# Autodesk Inventor assembly: CPS Team 1_Full Base Model
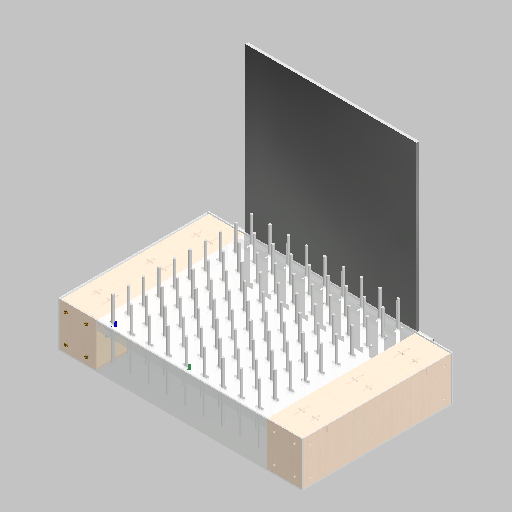
[picture p0: Inventor's stored thumbnail of the model, 512x512]
Saved by Autodesk Inventor 2026.1 (Build 301233000, 233)
## iProperties
Created: 2026-11-04
Part Number: CPS Team 1_Full Base Model
Document SubType Name: Assembly
Designer: FerdiaComerford
Author: FerdiaComerford
## iProperties of the stored document rear bearing.ipt
Created: 2026-11-04
Part Number: rear bearing
Material: Generic
Document SubType Name: Modeling
Designer: FerdiaComerford
Density: 1 g/cm^3
Appearance: Default
Author: FerdiaComerford
## iProperties of the stored document M3x10-Screw.ipt
Created: 2026-11-04
Part Number: M3x10-Screw
Material: Generic
Document SubType Name: Modeling
Designer: FerdiaComerford
Density: 1 g/cm^3
Appearance: Default
Author: FerdiaComerford
## iProperties of the stored document connector.ipt
Created: 2026-11-04
Part Number: connector
Material: Generic
Document SubType Name: Modeling
Designer: FerdiaComerford
Density: 1 g/cm^3
Appearance: Default
Author: FerdiaComerford
## iProperties of the stored document rear end cap.ipt
Created: 2026-11-04
Part Number: rear end cap
Material: Generic
Document SubType Name: Modeling
Designer: FerdiaComerford
Density: 1 g/cm^3
Appearance: Default
Author: FerdiaComerford
## iProperties of the stored document 17HS4401S_Stepper_Motor.iam
Created: 2024-09-10
Part Number: 17HS4401S_Stepper_Motor
Document SubType Name: Assembly
Designer: FerdiaComerford
Title: Open CASCADE Shape Model
Description: FreeCAD Model
Authorization: Unknown
Sending System: FreeCAD
Preprocessor: Open CASCADE STEP processor 7.6
Author: FerdiaComerford
## iProperties of the stored document stator.ipt
Created: 2026-11-04
Part Number: stator
Material: Generic
Document SubType Name: Modeling
Designer: FerdiaComerford
Density: 1 g/cm^3
Appearance: Default
Author: FerdiaComerford
## iProperties of the stored document front bearing.ipt
Created: 2026-11-04
Part Number: front bearing
Material: Generic
Document SubType Name: Modeling
Designer: FerdiaComerford
Density: 1 g/cm^3
Appearance: Default
Author: FerdiaComerford
## iProperties of the stored document front end cap.ipt
Created: 2026-11-04
Part Number: front end cap
Material: Generic
Document SubType Name: Modeling
Designer: FerdiaComerford
Density: 1 g/cm^3
Appearance: Default
Author: FerdiaComerford
## iProperties of the stored document shaft.ipt
Created: 2026-11-04
Part Number: shaft
Material: Generic
Document SubType Name: Modeling
Designer: FerdiaComerford
Density: 1 g/cm^3
Appearance: Default
Author: FerdiaComerford
## Documents named in this file (28)
- C:\Users\FerdiaComerford\Downloads\CPS Team 1_Full Base Model.iam
- C:\Users\FerdiaComerford\Downloads\Wheat Holder Mid Layer.ipt
- C:\Users\FerdiaComerford\Downloads\Wheat Holder Top Layer.ipt
- C:\Users\FerdiaComerford\Downloads\Wheat Holder Bottom Layer.ipt
- C:\Users\FerdiaComerford\Downloads\Wood Box Top.ipt
- C:\Users\FerdiaComerford\Downloads\Wood Box Short Side.ipt
- C:\Users\FerdiaComerford\Downloads\Wood Box Long End.ipt
- C:\Users\FerdiaComerford\Downloads\Acrlic Lond Side.ipt
- C:\Users\FerdiaComerford\Downloads\Acrylic Short Side.ipt
- C:\Users\FerdiaComerford\Downloads\Motor Mount.ipt
- C:\Users\FerdiaComerford\Downloads\Box Base.ipt
- C:\Users\FerdiaComerford\Downloads\support.ipt
- C:\Vault Workspace\CAD DESIGN\Components\FASTENERS\Brass\Brass Bolt Pan\DIN 85_ISO 1580_Brass Bolt Pan\FAS_0071.ipt
- C:\Users\FerdiaComerford\Downloads\Large Support.ipt
- C:\Users\FerdiaComerford\Downloads\Small Support.ipt
- **C:\Users\FerdiaComerford\Downloads\CPS Team 1_Full Base Model.iam*LocalDocs*xAaaaatbaAaaaaaaaAaaaavi0Zg*17HS4401S_Stepper_Motor.iam
- C:\Users\FerdiaComerford\Downloads\Straw.ipt
- C:\Users\FerdiaComerford\Downloads\CAM Shaft 3.ipt
- C:\Users\FerdiaComerford\Downloads\Mirror.ipt
- **C:\Users\FerdiaComerford\Downloads\CPS Team 1_Full Base Model.iam*LocalDocs*xAaaaagbaAaaaaaaaAaaaauxlCd*rear bearing.ipt
- **C:\Users\FerdiaComerford\Downloads\CPS Team 1_Full Base Model.iam*LocalDocs*xAaaaa1caAaaaaaaaAaaaapioAb*M3x10-Screw.ipt
- **C:\Users\FerdiaComerford\Downloads\CPS Team 1_Full Base Model.iam*LocalDocs*xAaaaa0caAaaaaaaaAaaaqgtkPa*connector.ipt
- **C:\Users\FerdiaComerford\Downloads\CPS Team 1_Full Base Model.iam*LocalDocs*xAaaaadcaAaaaaaaaAaaaaojlBe*rear end cap.ipt
- **C:\Users\FerdiaComerford\Downloads\CPS Team 1_Full Base Model.iam*LocalDocs*xAaaaqzdaAaaaaaaaAaaaar4kKc*shaft.ipt
- **C:\Users\FerdiaComerford\Downloads\CPS Team 1_Full Base Model.iam*LocalDocs*xAaaaanbaAaaaaaaaAaaaaue3Lc*stator.ipt
- **C:\Users\FerdiaComerford\Downloads\CPS Team 1_Full Base Model.iam*LocalDocs*xAaaaqldaAaaaaaaaAaaaqvu4Wd*front end cap.ipt
- **C:\Users\FerdiaComerford\Downloads\CPS Team 1_Full Base Model.iam*LocalDocs*xAaaaqvaaAaaaaaaaAaaaqtwsVh*front bearing.ipt
- C:\Users\FerdiaComerford\Downloads\17HS4401S_Stepper_Motor.step
## Components (116 placed, 18 different names)
1. Wheat Holder Mid Layer:1 — Mate:38
2. Wheat Holder Top Layer:1
3. Wheat Holder Bottom Layer:1
4. Wood Box Top:1
5. Wood Box Short Side:1 — Mate:29, Mate:30
6. Wood Box Long End:1 — Mate:33
7. Acrlic Lond Side:1 — Mate:21, Mate:22, Mate:23, Mate:24, Mate:25, Mate:26, Mate:27, Mate:28, Mate:37
8. Acrylic Short Side:1 — Mate:13, Mate:14, Mate:15, Mate:16, Mate:17, Mate:18, Mate:19, Mate:20
9. Motor Mount:1
10. Box Base:1
11. FAS_0071:1 — Mate:15, Mate:20
12. FAS_0071:2 — Mate:14, Mate:19
13. FAS_0071:3 — Mate:16, Mate:18
14. FAS_0071:4 — Mate:13, Mate:17
15. FAS_0071:5 — Mate:23, Mate:26
16. FAS_0071:6 — Mate:21, Mate:28
17. FAS_0071:7 — Mate:24, Mate:25
18. FAS_0071:8 — Mate:22, Mate:27
19. support:1 — Mate:35
20. Large Support:1
21. Small Support:1
22. 17HS4401S_Stepper_Motor:1 [sub-assembly] — Mate:29
23. 17HS4401S_Stepper_Motor:2 [sub-assembly] — Mate:30, Mate:33, Mate:34, Mate:35, Mate:36
24. 17HS4401S_Stepper_Motor:3 [sub-assembly]
25. CAM Shaft 3:1 — Mate:34, Mate:36
26. Mirror:1
27. Straw:2 — Mate:37, Mate:38
28. Straw:3
29. Straw:4
30. Straw:5
31. Straw:6
32. Straw:7
33. Straw:8
34. Straw:9
35. Straw:10
36. Straw:12
37. Straw:13
38. Straw:14
39. Straw:15
40. Straw:16
41. Straw:17
42. Straw:18
43. Straw:19
44. Straw:20
45. Straw:22
46. Straw:23
47. Straw:24
48. Straw:25
49. Straw:26
50. Straw:27
51. Straw:28
52. Straw:29
53. Straw:30
54. Straw:32
55. Straw:33
56. Straw:34
57. Straw:35
58. Straw:36
59. Straw:37
60. Straw:38
61. Straw:39
62. Straw:40
63. Straw:42
64. Straw:43
65. Straw:44
66. Straw:45
67. Straw:46
68. Straw:47
69. Straw:48
70. Straw:49
71. Straw:50
72. Straw:52
73. Straw:53
74. Straw:54
75. Straw:55
76. Straw:56
77. Straw:57
78. Straw:58
79. Straw:59
80. Straw:60
81. Straw:62
82. Straw:63
83. Straw:64
84. Straw:65
85. Straw:66
86. Straw:67
87. Straw:68
88. Straw:69
89. Straw:70
90. Straw:72
91. Straw:73
92. Straw:74
93. Straw:75
94. Straw:76
95. Straw:77
96. Straw:78
97. Straw:79
98. Straw:80
99. Straw:82
100. Straw:83
101. Straw:84
102. Straw:85
103. Straw:86
104. Straw:87
105. Straw:88
106. Straw:89
107. Straw:90
108. Straw:92
109. Straw:93
110. Straw:94
111. Straw:95
112. Straw:96
113. Straw:97
114. Straw:98
115. Straw:99
116. Straw:100
## Component patterns: (90 elements, first: Straw:2)
## Relationships (24: Mate 24)
- Mate:13: Acrylic Short Side:1 ↔ FAS_0071:4
- Mate:14: Acrylic Short Side:1 ↔ FAS_0071:2
- Mate:15: Acrylic Short Side:1 ↔ FAS_0071:1
- Mate:16: Acrylic Short Side:1 ↔ FAS_0071:3
- Mate:17: Acrylic Short Side:1 ↔ FAS_0071:4
- Mate:18: Acrylic Short Side:1 ↔ FAS_0071:3
- Mate:19: Acrylic Short Side:1 ↔ FAS_0071:2
- Mate:20: Acrylic Short Side:1 ↔ FAS_0071:1
- Mate:21: Acrlic Lond Side:1 ↔ FAS_0071:6
- Mate:22: Acrlic Lond Side:1 ↔ FAS_0071:8
- Mate:23: Acrlic Lond Side:1 ↔ FAS_0071:5
- Mate:24: Acrlic Lond Side:1 ↔ FAS_0071:7
- Mate:25: Acrlic Lond Side:1 ↔ FAS_0071:7
- Mate:26: Acrlic Lond Side:1 ↔ FAS_0071:5
- Mate:27: Acrlic Lond Side:1 ↔ FAS_0071:8
- Mate:28: Acrlic Lond Side:1 ↔ FAS_0071:6
- Mate:29: Wood Box Short Side:1 ↔ 17HS4401S_Stepper_Motor:1
- Mate:30: Wood Box Short Side:1 ↔ 17HS4401S_Stepper_Motor:2
- Mate:33: Wood Box Long End:1 ↔ 17HS4401S_Stepper_Motor:2
- Mate:34: 17HS4401S_Stepper_Motor:2 ↔ CAM Shaft 3:1
- Mate:35: support:1 ↔ 17HS4401S_Stepper_Motor:2
- Mate:36: 17HS4401S_Stepper_Motor:2 ↔ CAM Shaft 3:1
- Mate:37 (-4.9 mm): Acrlic Lond Side:1 ↔ Straw:2
- Mate:38: Wheat Holder Mid Layer:1 ↔ Straw:2
